# Autodesk Inventor assembly: Full_Assembly
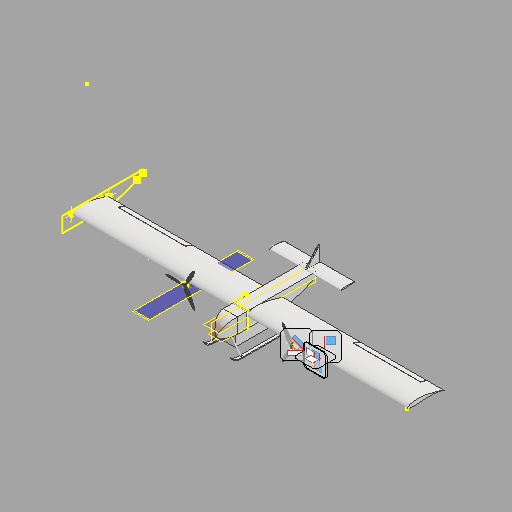
[picture p0: Inventor's stored thumbnail of the model, 512x512]
Saved by Autodesk Inventor 2027.1 (Build 311270010, 270A)
## iProperties
RuleStatus: InUse
Created: 2026-09-09
Part Number: Full_Assembly
Document SubType Name: Assembly
Designer: PWYNNE
Author: PWYNNE
## Documents named in this file (23)
- C:\Users\pwynne\Desktop\GITHUB\SWIFT-UAV\System_development\Heron\structural_model\v0.1.1\Full_Assembly.iam
- C:\Users\pwynne\Desktop\GITHUB\SWIFT-UAV\System_development\Heron\structural_model\v0.1.0\fuselage.ipt
- C:\Users\pwynne\Desktop\GITHUB\SWIFT-UAV\System_development\Heron\structural_model\v0.1.0\Wing_horizontal.ipt
- C:\Users\pwynne\Desktop\GITHUB\SWIFT-UAV\System_development\Heron\structural_model\v0.1.0\Wing_vertical.ipt
- C:\Users\pwynne\Desktop\GITHUB\SWIFT-UAV\System_development\Heron\structural_model\v0.1.0\Max_Payload.ipt
- C:\Users\pwynne\Desktop\GITHUB\SWIFT-UAV\System_development\Heron\structural_model\v0.1.0\Wing_horizontal_MIR3.ipt
- C:\Users\pwynne\Desktop\GITHUB\SWIFT-UAV\System_development\Heron\structural_model\v0.1.0\Landing_Skid.ipt
- C:\Users\pwynne\Desktop\GITHUB\SWIFT-UAV\System_development\Heron\structural_model\v0.1.0\Landing_Legs.ipt
- C:\Users\pwynne\Desktop\GITHUB\SWIFT-UAV\System_development\Heron\structural_model\v0.1.0\Prop_MIR.ipt
- C:\Users\pwynne\Desktop\GITHUB\SWIFT-UAV\System_development\Heron\structural_model\v0.1.0\Prop_MIR1.ipt
- C:\Users\pwynne\Desktop\GITHUB\SWIFT-UAV\System_development\Heron\structural_model\v0.1.0\Landing_Legs_MIR3.ipt
- C:\Users\pwynne\Desktop\GITHUB\SWIFT-UAV\System_development\Heron\structural_model\v0.1.0\Landing_Skid_MIR2.ipt
- C:\Users\pwynne\Desktop\GITHUB\SWIFT-UAV\System_development\Heron\structural_model\v0.1.0\Camera1.ipt
- C:\Users\pwynne\Desktop\GITHUB\SWIFT-UAV\System_development\Heron\structural_model\v0.1.0\Comm1.ipt
- C:\Users\pwynne\Desktop\GITHUB\SWIFT-UAV\System_development\Heron\structural_model\v0.1.0\Avionics1.ipt
- C:\Users\pwynne\Desktop\GITHUB\SWIFT-UAV\System_development\Heron\structural_model\v0.1.0\Avionics1_MIR.ipt
- C:\Users\pwynne\Desktop\GITHUB\SWIFT-UAV\System_development\Heron\structural_model\v0.1.0\Battery1.ipt
- C:\Users\pwynne\Desktop\GITHUB\SWIFT-UAV\System_development\Heron\structural_model\v0.1.1\Wing.ipt
- C:\Users\pwynne\Desktop\GITHUB\SWIFT-UAV\System_development\Heron\structural_model\v0.1.1\Motor.ipt
- C:\Users\pwynne\Desktop\GITHUB\SWIFT-UAV\System_development\Heron\structural_model\v0.1.1\FullProp.ipt
- C:\Users\pwynne\Desktop\GITHUB\SWIFT-UAV\System_development\Heron\structural_model\v0.1.1\Wing_MIR4.ipt
- C:\Users\pwynne\Desktop\GITHUB\SWIFT-UAV\System_development\Heron\structural_model\v0.1.1\Motor_MIR4.ipt
- C:\Users\pwynne\Desktop\GITHUB\SWIFT-UAV\System_development\Heron\structural_model\v0.1.1\FullProp_MIR3.ipt
## Components (22 placed, 22 different names)
1. fuselage:1 — Flush:2, Flush:3, Flush:5, Mate:5, Mate:6, Mate:7, Mate:9, Flush:12, Mate:10, Flush:13, Mate:11, Flush:15, Flush:26, Flush:27, Flush:28, Flush:29, Flush:30, Flush:31, Flush:32, Flush:33, Mate:25, Transitional:1, Mate:27, Angle:1, Angle:2, Mate:33, Mate:34, Mate:35, Flush:36, Mate:40, Mate:41
2. Wing_horizontal:1 — Mate:5, Mate:6, Flush:9, Mate:11
3. Wing_vertical:1 — Mate:7, Flush:9, Flush:13
4. Max_Payload:1 — Mate:9, Flush:12, Mate:10, Mate:13, Flush:16
5. Wing_horizontal_MIR3:1
6. Landing_Skid:1 — Mate:13, Mate:14, Flush:16, Flush:17, Mate:16, Mate:17
7. Landing_Legs:1 — Flush:17, Mate:16, Mate:17
8. Prop_MIR:1
9. Prop_MIR1:1
10. Landing_Legs_MIR3:1
11. Landing_Skid_MIR2:1 — Mate:24
12. Camera1:1 — Flush:26, Flush:27
13. Comm1:1 — Flush:28, Flush:29
14. Avionics1:1 — Flush:30, Flush:31
15. Avionics1_MIR:1
16. Battery1:1 — Flush:32, Flush:33
17. Wing:1 — Mate:25, Transitional:1, Mate:27, Angle:1, Mate:40, Mate:41
18. Motor:1 — Angle:2, Mate:36, Mate:37, Flush:35, Flush:37
19. FullProp:1 — Mate:36, Mate:37
20. Wing_MIR4:1
21. Motor_MIR4:1 — Mate:42, Flush:38, Flush:39, Mate:43
22. FullProp_MIR3:1 — Mate:42, Flush:38
## Relationships (49: Flush 24, Mate 22, Angle 2, Transitional 1)
- Flush:2 (-80 mm): fuselage:1
- Flush:3 (150 mm): fuselage:1
- Flush:4 (-1000 mm)
- Flush:5 (-250 mm): fuselage:1
- Mate:5 (-60 mm): fuselage:1 ↔ Wing_horizontal:1
- Mate:6: fuselage:1 ↔ Wing_horizontal:1
- Mate:7: fuselage:1 ↔ Wing_vertical:1
- Flush:9: Wing_horizontal:1 ↔ Wing_vertical:1
- Mate:9: fuselage:1 ↔ Max_Payload:1
- Flush:12 (-10 mm): fuselage:1 ↔ Max_Payload:1
- Mate:10: fuselage:1 ↔ Max_Payload:1
- Flush:13: fuselage:1 ↔ Wing_vertical:1
- Mate:11: fuselage:1 ↔ Wing_horizontal:1
- Mate:13 (30 mm): Max_Payload:1 ↔ Landing_Skid:1
- Flush:15: fuselage:1
- Mate:14 (130 mm): Landing_Skid:1
- Flush:16 (-10 mm): Max_Payload:1 ↔ Landing_Skid:1
- Flush:17: Landing_Skid:1 ↔ Landing_Legs:1
- Mate:16 (-15 mm): Landing_Skid:1 ↔ Landing_Legs:1
- Mate:17 (12.5 mm): Landing_Skid:1 ↔ Landing_Legs:1
- Mate:24 (130 mm): Landing_Skid_MIR2:1
- Flush:26: fuselage:1 ↔ Camera1:1
- Flush:27: fuselage:1 ↔ Camera1:1
- Flush:28: fuselage:1 ↔ Comm1:1
- Flush:29: fuselage:1 ↔ Comm1:1
- Flush:30: fuselage:1 ↔ Avionics1:1
- Flush:31: fuselage:1 ↔ Avionics1:1
- Flush:32: fuselage:1 ↔ Battery1:1
- Flush:33: fuselage:1 ↔ Battery1:1
- Mate:25: fuselage:1 ↔ Wing:1
- Transitional:1: fuselage:1 ↔ Wing:1
- Mate:27: fuselage:1 ↔ Wing:1
- Angle:1 (-4.53 deg): fuselage:1 ↔ Wing:1
- Angle:2 (0 deg): fuselage:1 ↔ Motor:1
- Mate:33: fuselage:1
- Mate:34: fuselage:1
- Mate:35: fuselage:1
- Mate:36: Motor:1 ↔ FullProp:1
- Mate:37: Motor:1 ↔ FullProp:1
- Flush:34 (-95.25 mm)
- Flush:35: Motor:1
- Flush:36 (-48 mm): fuselage:1
- Flush:37: Motor:1
- Mate:40: fuselage:1 ↔ Wing:1
- Mate:41: fuselage:1 ↔ Wing:1
- Mate:42: Motor_MIR4:1 ↔ FullProp_MIR3:1
- Flush:38: Motor_MIR4:1 ↔ FullProp_MIR3:1
- Flush:39: Motor_MIR4:1
- Mate:43: Motor_MIR4:1
